# Autodesk Inventor assembly: ASSEMBLY_DUT_Ant_Rotator_REVB
(part 4 of 5)
- Mate:412: 3DP_PLA_B_Axis_Rotating_Stage_Fiberglass_pipes_mount_clamp:1 ↔ COTS_DREMEC_8G206M6X50_M6x50_Nylon_Screw:44
- Mate:413: 3DP_PLA_B_Axis_Rotating_Stage_Fiberglass_pipes_mount_clamp:1 ↔ COTS_DREMEC_8G206M6X50_M6x50_Nylon_Screw:43
- Mate:414: 3DP_PLA_B_Axis_Rotating_Stage_Fiberglass_pipes_mount_clamp:1 ↔ COTS_DREMEC_8G206M6X50_M6x50_Nylon_Screw:42
- Mate:415: 3DP_PLA_B_Axis_Rotating_Stage_Fiberglass_pipes_mount_clamp:1 ↔ COTS_DREMEC_8G206M6X50_M6x50_Nylon_Screw:45
- Mate:416: 3DP_PLA_B_Axis_Rotating_Stage_Fiberglass_pipes_mount_clamp:1 ↔ COTS_DREMEC_8G206M6X50_M6x50_Nylon_Screw:46
- Mate:417: 3DP_PLA_B_Axis_Rotating_Stage_Fiberglass_pipes_mount_clamp:1 ↔ COTS_DREMEC_8G206M6X50_M6x50_Nylon_Screw:47
- Mate:418: 3DP_PLA_B_Axis_Rotating_Stage_Fiberglass_pipes_mount_clamp:2 ↔ COTS_DREMEC_8G206M6X50_M6x50_Nylon_Screw:48
- Mate:419: 3DP_PLA_B_Axis_Rotating_Stage_Fiberglass_pipes_mount_clamp:2 ↔ COTS_DREMEC_8G206M6X50_M6x50_Nylon_Screw:49
- Mate:420: 3DP_PLA_B_Axis_Rotating_Stage_Fiberglass_pipes_mount_clamp:2 ↔ COTS_DREMEC_8G206M6X50_M6x50_Nylon_Screw:50
- Mate:421: 3DP_PLA_B_Axis_Rotating_Stage_Fiberglass_pipes_mount_clamp:2 ↔ COTS_DREMEC_8G206M6X50_M6x50_Nylon_Screw:51
- Mate:422: 3DP_PLA_B_Axis_Rotating_Stage_Fiberglass_pipes_mount_clamp:2 ↔ COTS_DREMEC_8G206M6X50_M6x50_Nylon_Screw:52
- Mate:423: 3DP_PLA_B_Axis_Rotating_Stage_Fiberglass_pipes_mount_clamp:2 ↔ COTS_DREMEC_8G206M6X50_M6x50_Nylon_Screw:53
- Mate:424: 3DP_PLA_B_Axis_Rotating_Stage_Fiberglass_pipes_mount_clamp:2 ↔ COTS_DREMEC_8G206M6X50_M6x50_Nylon_Screw:52
- Mate:425: 3DP_PLA_B_Axis_Rotating_Stage_Fiberglass_pipes_mount_clamp:2 ↔ COTS_DREMEC_8G206M6X50_M6x50_Nylon_Screw:50
- Mate:426: 3DP_PLA_B_Axis_Rotating_Stage_Fiberglass_pipes_mount_clamp:2 ↔ COTS_DREMEC_8G206M6X50_M6x50_Nylon_Screw:53
- Mate:427: 3DP_PLA_B_Axis_Rotating_Stage_Fiberglass_pipes_mount_clamp:2 ↔ COTS_DREMEC_8G206M6X50_M6x50_Nylon_Screw:49
- Mate:428: 3DP_PLA_B_Axis_Rotating_Stage_Fiberglass_pipes_mount_clamp:2 ↔ COTS_DREMEC_8G206M6X50_M6x50_Nylon_Screw:48
- Mate:429: 3DP_PLA_B_Axis_Rotating_Stage_Fiberglass_pipes_mount_clamp:2 ↔ COTS_DREMEC_8G206M6X50_M6x50_Nylon_Screw:51
- Mate:430: 3DP_PLA_B_Axis_Rotating_Stage_Fiberglass_pipes_mount_clamp:1 ↔ COTS_DREMEC_8G206M6X50_M6x50_Nylon_Screw:43
- Mate:431: 3DP_PLA_B_Axis_Rotating_Stage_Fiberglass_pipes_mount_clamp:1 ↔ COTS_DREMEC_8G206M6X50_M6x50_Nylon_Screw:42
- Mate:432: 3DP_PLA_B_Axis_Rotating_Stage_Fiberglass_pipes_mount_clamp:1 ↔ COTS_DREMEC_8G206M6X50_M6x50_Nylon_Screw:44
- Mate:433: 3DP_PLA_B_Axis_Rotating_Stage_Fiberglass_pipes_mount_clamp:1 ↔ COTS_DREMEC_8G206M6X50_M6x50_Nylon_Screw:46
- Mate:434: 3DP_PLA_B_Axis_Rotating_Stage_Fiberglass_pipes_mount_clamp:1 ↔ COTS_DREMEC_8G206M6X50_M6x50_Nylon_Screw:47
- Mate:435: 3DP_PLA_B_Axis_Rotating_Stage_Fiberglass_pipes_mount_clamp:1 ↔ COTS_DREMEC_8G206M6X50_M6x50_Nylon_Screw:45
- Mate:436: 3DP_PLA_B_Axis_Rotating_Stage:1 ↔ COTS_BOSSARD_1400444_M6_Nylon_Nut:44
- Mate:437: 3DP_PLA_B_Axis_Rotating_Stage:1 ↔ COTS_BOSSARD_1400444_M6_Nylon_Nut:47
- Mate:438: 3DP_PLA_B_Axis_Rotating_Stage:1 ↔ COTS_BOSSARD_1400444_M6_Nylon_Nut:50
- Mate:439: 3DP_PLA_B_Axis_Rotating_Stage:1 ↔ COTS_BOSSARD_1400444_M6_Nylon_Nut:53
- Mate:440: 3DP_PLA_B_Axis_Rotating_Stage:1 ↔ COTS_BOSSARD_1400444_M6_Nylon_Nut:52
- Mate:441: 3DP_PLA_B_Axis_Rotating_Stage:1 ↔ COTS_BOSSARD_1400444_M6_Nylon_Nut:49
- Mate:442: 3DP_PLA_B_Axis_Rotating_Stage:1 ↔ COTS_BOSSARD_1400444_M6_Nylon_Nut:46
- Mate:443: 3DP_PLA_B_Axis_Rotating_Stage:1 ↔ COTS_BOSSARD_1400444_M6_Nylon_Nut:43
- Mate:444: 3DP_PLA_B_Axis_Rotating_Stage:1 ↔ COTS_BOSSARD_1400444_M6_Nylon_Nut:42
- Mate:445: 3DP_PLA_B_Axis_Rotating_Stage:1 ↔ COTS_BOSSARD_1400444_M6_Nylon_Nut:51
- Mate:446: 3DP_PLA_B_Axis_Rotating_Stage:1 ↔ COTS_BOSSARD_1400444_M6_Nylon_Nut:45
- Mate:447: 3DP_PLA_B_Axis_Rotating_Stage:1 ↔ COTS_BOSSARD_1400444_M6_Nylon_Nut:48
- Mate:448: COTS_BOSSARD_1400444_M6_Nylon_Nut:48 ↔ COTS_DREMEC_8G206M6X50_M6x50_Nylon_Screw:43
- Mate:449: COTS_BOSSARD_1400444_M6_Nylon_Nut:45 ↔ COTS_DREMEC_8G206M6X50_M6x50_Nylon_Screw:47
- Mate:450: COTS_BOSSARD_1400444_M6_Nylon_Nut:51 ↔ COTS_DREMEC_8G206M6X50_M6x50_Nylon_Screw:44
- Mate:451: COTS_BOSSARD_1400444_M6_Nylon_Nut:46 ↔ COTS_DREMEC_8G206M6X50_M6x50_Nylon_Screw:46
- Mate:452: COTS_BOSSARD_1400444_M6_Nylon_Nut:43 ↔ COTS_DREMEC_8G206M6X50_M6x50_Nylon_Screw:45
- Mate:453: COTS_BOSSARD_1400444_M6_Nylon_Nut:42 ↔ COTS_DREMEC_8G206M6X50_M6x50_Nylon_Screw:42
- Mate:454: COTS_BOSSARD_1400444_M6_Nylon_Nut:50 ↔ COTS_DREMEC_8G206M6X50_M6x50_Nylon_Screw:52
- Mate:455: COTS_BOSSARD_1400444_M6_Nylon_Nut:49 ↔ COTS_DREMEC_8G206M6X50_M6x50_Nylon_Screw:50
- Mate:456: COTS_BOSSARD_1400444_M6_Nylon_Nut:47 ↔ COTS_DREMEC_8G206M6X50_M6x50_Nylon_Screw:53
- Mate:457: COTS_BOSSARD_1400444_M6_Nylon_Nut:52 ↔ COTS_DREMEC_8G206M6X50_M6x50_Nylon_Screw:49
- Mate:458: COTS_BOSSARD_1400444_M6_Nylon_Nut:44 ↔ COTS_DREMEC_8G206M6X50_M6x50_Nylon_Screw:48
- Mate:459: COTS_BOSSARD_1400444_M6_Nylon_Nut:53 ↔ COTS_DREMEC_8G206M6X50_M6x50_Nylon_Screw:51
- Angle:44 (0 deg): 3DP_PLA_B_Axis_Rotating_Stage:1 ↔ COTS_BOSSARD_1400444_M6_Nylon_Nut:44
- Angle:45 (0 deg): 3DP_PLA_B_Axis_Rotating_Stage:1 ↔ COTS_BOSSARD_1400444_M6_Nylon_Nut:53
- Angle:46 (0 deg): 3DP_PLA_B_Axis_Rotating_Stage:1 ↔ COTS_BOSSARD_1400444_M6_Nylon_Nut:52
- Angle:47 (0 deg): 3DP_PLA_B_Axis_Rotating_Stage:1 ↔ COTS_BOSSARD_1400444_M6_Nylon_Nut:47
- Angle:48 (0 deg): 3DP_PLA_B_Axis_Rotating_Stage:1 ↔ COTS_BOSSARD_1400444_M6_Nylon_Nut:50
- Angle:49 (0 deg): 3DP_PLA_B_Axis_Rotating_Stage:1 ↔ COTS_BOSSARD_1400444_M6_Nylon_Nut:49
- Angle:50 (0 deg): 3DP_PLA_B_Axis_Rotating_Stage:1 ↔ COTS_BOSSARD_1400444_M6_Nylon_Nut:42
- Angle:51 (0 deg): 3DP_PLA_B_Axis_Rotating_Stage:1 ↔ COTS_BOSSARD_1400444_M6_Nylon_Nut:48
- Angle:52 (0 deg): 3DP_PLA_B_Axis_Rotating_Stage:1 ↔ COTS_BOSSARD_1400444_M6_Nylon_Nut:43
- Angle:53 (0 deg): 3DP_PLA_B_Axis_Rotating_Stage:1 ↔ COTS_BOSSARD_1400444_M6_Nylon_Nut:45
- Angle:54 (-90 deg): 3DP_PLA_Fiberglass_Pipe_Corner_Bracket:2 ↔ 3DP_PLA_B_Axis_Bearing_Mounting_Plate:1
- Mate:460: 3DP_PLA_B_Axis_Main_Pulley:1 ↔ 3DP_PLA_B_Axis_Rotating_Stage:1
- Mate:461: 3DP_PLA_B_Axis_Main_Pulley:1 ↔ COTS_DREMEC_8G206M6X50_M6x50_Nylon_Screw:55
- Mate:462: 3DP_PLA_B_Axis_Main_Pulley:1 ↔ COTS_DREMEC_8G206M6X50_M6x50_Nylon_Screw:54
- Mate:463: 3DP_PLA_B_Axis_Main_Pulley:1 ↔ COTS_DREMEC_8G206M6X50_M6x50_Nylon_Screw:56
- Mate:464: 3DP_PLA_B_Axis_Main_Pulley:1 ↔ COTS_DREMEC_8G206M6X50_M6x50_Nylon_Screw:57
- Mate:465: 3DP_PLA_B_Axis_Main_Pulley:1 ↔ COTS_DREMEC_8G206M6X50_M6x50_Nylon_Screw:59
- Mate:466: 3DP_PLA_B_Axis_Main_Pulley:1 ↔ COTS_DREMEC_8G206M6X50_M6x50_Nylon_Screw:58
- Mate:467: 3DP_PLA_B_Axis_Main_Pulley:1 ↔ COTS_DREMEC_8G206M6X50_M6x50_Nylon_Screw:54
- Mate:468: 3DP_PLA_B_Axis_Main_Pulley:1 ↔ COTS_DREMEC_8G206M6X50_M6x50_Nylon_Screw:56
- Mate:469: 3DP_PLA_B_Axis_Main_Pulley:1 ↔ COTS_DREMEC_8G206M6X50_M6x50_Nylon_Screw:58
- Mate:470: 3DP_PLA_B_Axis_Main_Pulley:1 ↔ COTS_DREMEC_8G206M6X50_M6x50_Nylon_Screw:59
- Mate:471: 3DP_PLA_B_Axis_Main_Pulley:1 ↔ COTS_DREMEC_8G206M6X50_M6x50_Nylon_Screw:57
- Mate:472: 3DP_PLA_B_Axis_Main_Pulley:1 ↔ COTS_DREMEC_8G206M6X50_M6x50_Nylon_Screw:55
- Mate:473: 3DP_PLA_B_Axis_Rotating_Stage:1 ↔ COTS_BOSSARD_1400444_M6_Nylon_Nut:55
- Mate:474: 3DP_PLA_B_Axis_Rotating_Stage:1 ↔ COTS_BOSSARD_1400444_M6_Nylon_Nut:54
- Mate:475: 3DP_PLA_B_Axis_Rotating_Stage:1 ↔ COTS_BOSSARD_1400444_M6_Nylon_Nut:56
- Mate:476: 3DP_PLA_B_Axis_Rotating_Stage:1 ↔ COTS_BOSSARD_1400444_M6_Nylon_Nut:57
- Mate:477: 3DP_PLA_B_Axis_Rotating_Stage:1 ↔ COTS_BOSSARD_1400444_M6_Nylon_Nut:59
- Mate:478: 3DP_PLA_B_Axis_Rotating_Stage:1 ↔ COTS_BOSSARD_1400444_M6_Nylon_Nut:58
- Mate:479: COTS_BOSSARD_1400444_M6_Nylon_Nut:59 ↔ COTS_DREMEC_8G206M6X50_M6x50_Nylon_Screw:55
- Mate:480: COTS_BOSSARD_1400444_M6_Nylon_Nut:58 ↔ COTS_DREMEC_8G206M6X50_M6x50_Nylon_Screw:57
- Mate:481: COTS_BOSSARD_1400444_M6_Nylon_Nut:55 ↔ COTS_DREMEC_8G206M6X50_M6x50_Nylon_Screw:54
- Mate:482: COTS_BOSSARD_1400444_M6_Nylon_Nut:54 ↔ COTS_DREMEC_8G206M6X50_M6x50_Nylon_Screw:56
- Mate:483: COTS_BOSSARD_1400444_M6_Nylon_Nut:56 ↔ COTS_DREMEC_8G206M6X50_M6x50_Nylon_Screw:58
- Mate:484: COTS_BOSSARD_1400444_M6_Nylon_Nut:57 ↔ COTS_DREMEC_8G206M6X50_M6x50_Nylon_Screw:59
- Angle:55 (0 deg): 3DP_PLA_B_Axis_Rotating_Stage:1 ↔ COTS_BOSSARD_1400444_M6_Nylon_Nut:55
- Angle:56 (0 deg): 3DP_PLA_B_Axis_Rotating_Stage:1 ↔ COTS_BOSSARD_1400444_M6_Nylon_Nut:54
- Angle:57 (0 deg): 3DP_PLA_B_Axis_Rotating_Stage:1 ↔ COTS_BOSSARD_1400444_M6_Nylon_Nut:56
- Angle:58 (0 deg): 3DP_PLA_B_Axis_Rotating_Stage:1 ↔ COTS_BOSSARD_1400444_M6_Nylon_Nut:57
- Angle:59 (0 deg): 3DP_PLA_B_Axis_Rotating_Stage:1 ↔ COTS_BOSSARD_1400444_M6_Nylon_Nut:58
- Angle:60 (0 deg): 3DP_PLA_B_Axis_Rotating_Stage:1 ↔ COTS_BOSSARD_1400444_M6_Nylon_Nut:59
- Mate:485: COTS_GENERIC_6016_80x125x22mm_POM_Ball_Bearing:1 ↔ 3DP_PLA_B_Axis_End_Cap:1
- Mate:486: 3DP_PLA_B_Axis_Main_Pulley:1 ↔ 3DP_PLA_B_Axis_End_Cap:1
- Mate:487: 3DP_PLA_B_Axis_Main_Pulley:1 ↔ 3DP_PLA_B_Axis_End_Cap:1
- Mate:488: 3DP_PLA_B_Axis_Main_Pulley:1 ↔ COTS_DREMEC_8G206M6X50_M6x50_Nylon_Screw:62
- Mate:489: 3DP_PLA_B_Axis_Main_Pulley:1 ↔ COTS_DREMEC_8G206M6X50_M6x50_Nylon_Screw:61
- Mate:490: 3DP_PLA_B_Axis_Main_Pulley:1 ↔ COTS_DREMEC_8G206M6X50_M6x50_Nylon_Screw:60
- Mate:491: 3DP_PLA_B_Axis_Main_Pulley:1 ↔ COTS_DREMEC_8G206M6X50_M6x50_Nylon_Screw:61
- Mate:492: 3DP_PLA_B_Axis_Main_Pulley:1 ↔ COTS_DREMEC_8G206M6X50_M6x50_Nylon_Screw:60
- Mate:493: 3DP_PLA_B_Axis_Main_Pulley:1 ↔ COTS_DREMEC_8G206M6X50_M6x50_Nylon_Screw:62
- Mate:494: 3DP_PLA_B_Axis_End_Cap:1 ↔ COTS_BOSSARD_1400444_M6_Nylon_Nut:61
- Mate:495: 3DP_PLA_B_Axis_End_Cap:1 ↔ COTS_BOSSARD_1400444_M6_Nylon_Nut:62
- Mate:496: 3DP_PLA_B_Axis_End_Cap:1 ↔ COTS_BOSSARD_1400444_M6_Nylon_Nut:60
- Mate:497: COTS_BOSSARD_1400444_M6_Nylon_Nut:60 ↔ COTS_DREMEC_8G206M6X50_M6x50_Nylon_Screw:62
- Mate:498: COTS_BOSSARD_1400444_M6_Nylon_Nut:62 ↔ COTS_DREMEC_8G206M6X50_M6x50_Nylon_Screw:60
- Mate:499: COTS_BOSSARD_1400444_M6_Nylon_Nut:61 ↔ COTS_DREMEC_8G206M6X50_M6x50_Nylon_Screw:61
- Angle:61 (0 deg): 3DP_PLA_B_Axis_End_Cap:1 ↔ COTS_BOSSARD_1400444_M6_Nylon_Nut:61
- Angle:62 (0 deg): 3DP_PLA_B_Axis_End_Cap:1 ↔ COTS_BOSSARD_1400444_M6_Nylon_Nut:62
- Angle:63 (0 deg): 3DP_PLA_B_Axis_End_Cap:1 ↔ COTS_BOSSARD_1400444_M6_Nylon_Nut:60
- Mate:500: COTS_CARBONCENTER_Fiberglass_Tube_27x24x383mm:8 ↔ 3DP_PLA_Antenna_Boom_Coax_Feed_Horn_REVB:1
- Mate:501: COTS_CARBONCENTER_Fiberglass_Tube_27x24x383mm:7 ↔ 3DP_PLA_Antenna_Boom_Coax_Feed_Horn_REVB:1
- Flush:22 (102.5 mm): COTS_CARBONCENTER_Fiberglass_Tube_27x24x383mm:8 ↔ 3DP_PLA_Antenna_Boom_Coax_Feed_Horn_REVB:1
- Mate:502: COTS_CARBONCENTER_Fiberglass_Tube_27x24x383mm:8 ↔ 3DP_PLA_Antenna_Boom_Fiberglass_Pipe_Clamp:1
- Mate:503: COTS_CARBONCENTER_Fiberglass_Tube_27x24x383mm:7 ↔ 3DP_PLA_Antenna_Boom_Fiberglass_Pipe_Clamp:1
- Flush:23: 3DP_PLA_Antenna_Boom_Fiberglass_Pipe_Clamp:1 ↔ 3DP_PLA_Antenna_Boom_Coax_Feed_Horn_REVB:1
- Mate:504: 3DP_PLA_Antenna_Boom_Coax_Feed_Horn_REVB:1 ↔ COTS_DREMEC_8G206M6X50_M6x50_Nylon_Screw:63
- Mate:505: 3DP_PLA_Antenna_Boom_Coax_Feed_Horn_REVB:1 ↔ COTS_DREMEC_8G206M6X50_M6x50_Nylon_Screw:64
- Mate:506: 3DP_PLA_Antenna_Boom_Coax_Feed_Horn_REVB:1 ↔ COTS_DREMEC_8G206M6X50_M6x50_Nylon_Screw:65
- Mate:507: 3DP_PLA_Antenna_Boom_Coax_Feed_Horn_REVB:1 ↔ COTS_DREMEC_8G206M6X50_M6x50_Nylon_Screw:66
- Mate:508: 3DP_PLA_Antenna_Boom_Coax_Feed_Horn_REVB:1 ↔ COTS_DREMEC_8G206M6X50_M6x50_Nylon_Screw:66
- Mate:509: 3DP_PLA_Antenna_Boom_Coax_Feed_Horn_REVB:1 ↔ COTS_DREMEC_8G206M6X50_M6x50_Nylon_Screw:64
- Mate:510: 3DP_PLA_Antenna_Boom_Coax_Feed_Horn_REVB:1 ↔ COTS_DREMEC_8G206M6X50_M6x50_Nylon_Screw:63
- Mate:511: 3DP_PLA_Antenna_Boom_Coax_Feed_Horn_REVB:1 ↔ COTS_DREMEC_8G206M6X50_M6x50_Nylon_Screw:65
- Mate:512: 3DP_PLA_Antenna_Boom_Fiberglass_Pipe_Clamp:1 ↔ COTS_BOSSARD_1400444_M6_Nylon_Nut:63
- Mate:513: 3DP_PLA_Antenna_Boom_Fiberglass_Pipe_Clamp:1 ↔ COTS_BOSSARD_1400444_M6_Nylon_Nut:66
- Mate:514: 3DP_PLA_Antenna_Boom_Fiberglass_Pipe_Clamp:1 ↔ COTS_BOSSARD_1400444_M6_Nylon_Nut:65
- Mate:515: 3DP_PLA_Antenna_Boom_Fiberglass_Pipe_Clamp:1 ↔ COTS_BOSSARD_1400444_M6_Nylon_Nut:64
- Mate:516: COTS_BOSSARD_1400444_M6_Nylon_Nut:64 ↔ COTS_DREMEC_8G206M6X50_M6x50_Nylon_Screw:66
- Mate:517: COTS_BOSSARD_1400444_M6_Nylon_Nut:66 ↔ COTS_DREMEC_8G206M6X50_M6x50_Nylon_Screw:64
- Mate:518: COTS_BOSSARD_1400444_M6_Nylon_Nut:63 ↔ COTS_DREMEC_8G206M6X50_M6x50_Nylon_Screw:63
- Mate:519: COTS_BOSSARD_1400444_M6_Nylon_Nut:65 ↔ COTS_DREMEC_8G206M6X50_M6x50_Nylon_Screw:65
- Mate:520: COTS_BYTECHLAB_Coaxial_Feed_Horn:1 ↔ 3DP_PLA_Antenna_Boom_Coax_Feed_Horn_REVB:1
- Mate:521: COTS_BYTECHLAB_Coaxial_Feed_Horn:1 ↔ 3DP_PLA_Antenna_Boom_Coax_Feed_Horn_REVB:1
- Mate:522: COTS_BYTECHLAB_Coaxial_Feed_Horn:1 ↔ 3DP_PLA_Antenna_Boom_Coax_Feed_Horn_REVB:1
- Mate:576: 3DP_PLA_A_Axis_Bearing_Base:1 ↔ COTS_Profihot_HC-2-22x16_Zip_Tie_Anchor:1
- Angle:64 (0 deg): 3DP_PLA_A_Axis_Bearing_Base:1 ↔ COTS_Profihot_HC-2-22x16_Zip_Tie_Anchor:1
- Mate:577: 3DP_PLA_A_Axis_Bearing_Base:1 ↔ COTS_BOSSARD_1386883_M4_Threaded_Insert:1
- Flush:24: 3DP_PLA_A_Axis_Bearing_Base:1 ↔ COTS_BOSSARD_1386883_M4_Threaded_Insert:1
- Mate:578: COTS_Profihot_HC-2-22x16_Zip_Tie_Anchor:1 ↔ COTS_BOSSARD_1386883_M4_Threaded_Insert:1
- Mate:579: COTS_Profihot_HC-2-22x16_Zip_Tie_Anchor:1 ↔ DIN 125-1 A A 4,3:1
- Mate:580: COTS_Profihot_HC-2-22x16_Zip_Tie_Anchor:1 ↔ DIN 125-1 A A 4,3:1
- Insert:9: DIN 125-1 A A 4,3:1 ↔ ISO 7380-1 M4 x 8:1
- Mate:581: 3DP_PLA_Fiberglass_Pipe_Corner_Bracket_Clamp_and_B_axis_Stepper_Mount_REVB:1 ↔ COTS_Profihot_HC-2-22x16_Zip_Tie_Anchor:2
- Angle:65 (0 deg): COTS_MKS_SERVO42D_40mm:2 ↔ COTS_Profihot_HC-2-22x16_Zip_Tie_Anchor:2
- Mate:582: 3DP_PLA_Fiberglass_Pipe_Corner_Bracket_Clamp_and_B_axis_Stepper_Mount_REVB:1 ↔ DIN 125-1 A A 4,3:2
- Mate:583: COTS_Profihot_HC-2-22x16_Zip_Tie_Anchor:2 ↔ DIN 125-1 A A 4,3:2
- Insert:10: DIN 125-1 A A 4,3:2 ↔ ISO 7380-1 M4 x 16:1
- Mate:584: 3DP_PLA_Fiberglass_Pipe_Corner_Bracket_Clamp_and_B_axis_Stepper_Mount_REVB:1 ↔ DIN 125-1 A A 4,3:3
- Mate:585: 3DP_PLA_Fiberglass_Pipe_Corner_Bracket_Clamp_and_B_axis_Stepper_Mount_REVB:1 ↔ DIN 125-1 A A 4,3:3
- Insert:11: DIN 125-1 A A 4,3:3 ↔ DIN 934 - replaced by DIN EN 24032/28673/28674 M4:24
- Mate:586: 3DP_PLA_B_Axis_Bearing_Mounting_Plate:2 ↔ COTS_Profihot_HC-2-22x16_Zip_Tie_Anchor:3
- Angle:66 (0 deg): 3DP_PLA_B_Axis_Bearing_Mounting_Plate:2 ↔ COTS_Profihot_HC-2-22x16_Zip_Tie_Anchor:3
- Mate:587: 3DP_PLA_B_Axis_Bearing_Mounting_Plate:2 ↔ COTS_Profihot_HC-2-22x16_Zip_Tie_Anchor:3
- Mate:588: 3DP_PLA_B_Axis_Bearing_Mounting_Plate:2 ↔ COTS_DREMEC_8G206M5X08_M5x8_Nylon_Screw:1
- Mate:589: COTS_Profihot_HC-2-22x16_Zip_Tie_Anchor:3 ↔ COTS_DREMEC_8G206M5X08_M5x8_Nylon_Screw:1
- Mate:590: COTS_CARBONCENTER_Fiberglass_Tube_27x24x383mm:5 ↔ 3DP_PLA_B_Axis_Cable_Galnd:1
- Mate:591: COTS_CARBONCENTER_Fiberglass_Tube_27x24x383mm:5 ↔ 3DP_PLA_B_Axis_Cable_Galnd:1
- Mate:592: ASSEMBLY_HTD3M_Idler_A_Axis:2 ↔ 3DP_PLA_A_Axis_Idler_Stiffening_Bracket:1
- Mate:593: ASSEMBLY_HTD3M_Idler_A_Axis:2 ↔ 3DP_PLA_A_Axis_Idler_Stiffening_Bracket:1
- Mate:594: ASSEMBLY_HTD3M_Idler_A_Axis:1 ↔ 3DP_PLA_A_Axis_Idler_Stiffening_Bracket:1
- Mate:595: 3DP_PLA_A_Axis_Idler_Stiffening_Bracket:1 ↔ DIN 912 - replaced by DIN EN ISO 4762 M4 x 35:3
- Mate:596: 3DP_PLA_A_Axis_Idler_Stiffening_Bracket:1 ↔ DIN 912 - replaced by DIN EN ISO 4762 M4 x 35:3
- Mate:597: 3DP_PLA_A_Axis_Idler_Stiffening_Bracket:1 ↔ DIN 912 - replaced by DIN EN ISO 4762 M4 x 35:4
- Mate:598: 3DP_PLA_A_Axis_Idler_Stiffening_Bracket:1 ↔ DIN 912 - replaced by DIN EN ISO 4762 M4 x 35:4
- Mate:599: 3DP_PLA_A_Axis_Idler_Stiffening_Bracket:1 ↔ DIN 934 - replaced by DIN EN 24032/28673/28674 M4:25
- Mate:600: 3DP_PLA_A_Axis_Stepper_Mount_REVB:1 ↔ DIN 934 - replaced by DIN EN 24032/28673/28674 M4:25
- Mate:601: 3DP_PLA_A_Axis_Idler_Stiffening_Bracket:1 ↔ DIN 934 - replaced by DIN EN 24032/28673/28674 M4:26
- Mate:602: 3DP_PLA_A_Axis_Stepper_Mount_REVB:1 ↔ DIN 934 - replaced by DIN EN 24032/28673/28674 M4:26
- Mate:603: ASSEMBLY_HTD3M_Idler_B_Axis:2 ↔ 3DP_PLA_B_Axis_Idler_Stiffening_Bracket:1
- Mate:604: ASSEMBLY_HTD3M_Idler_B_Axis:2 ↔ 3DP_PLA_B_Axis_Idler_Stiffening_Bracket:1
- Mate:605: ASSEMBLY_HTD3M_Idler_B_Axis:1 ↔ 3DP_PLA_B_Axis_Idler_Stiffening_Bracket:1
- Mate:606: 3DP_PLA_B_Axis_Idler_Stiffening_Bracket:1 ↔ ISO 7380-1 M4 x 40:12
- Mate:607: 3DP_PLA_B_Axis_Idler_Stiffening_Bracket:1 ↔ ISO 7380-1 M4 x 40:12
- Mate:608: 3DP_PLA_B_Axis_Idler_Stiffening_Bracket:1 ↔ ISO 7380-1 M4 x 40:13
- Mate:609: 3DP_PLA_B_Axis_Idler_Stiffening_Bracket:1 ↔ ISO 7380-1 M4 x 40:13
- Mate:610: 3DP_PLA_B_Axis_Idler_Stiffening_Bracket:1 ↔ DIN 934 - replaced by DIN EN 24032/28673/28674 M4:27
- Mate:611: 3DP_PLA_Fiberglass_Pipe_Corner_Bracket_Clamp_and_B_axis_Stepper_Mount_REVB:1 ↔ DIN 934 - replaced by DIN EN 24032/28673/28674 M4:27
- Mate:612: 3DP_PLA_B_Axis_Idler_Stiffening_Bracket:1 ↔ DIN 934 - replaced by DIN EN 24032/28673/28674 M4:28
- Mate:613: 3DP_PLA_Fiberglass_Pipe_Corner_Bracket_Clamp_and_B_axis_Stepper_Mount_REVB:1 ↔ DIN 934 - replaced by DIN EN 24032/28673/28674 M4:28
- Mate:625: 3DP_PLA_A_Axis_Bearing_Base:1 ↔ 3DP_PLA_A_Axis_Bearing_Base_Stand_Mount_REVB:1
- Mate:627: 3DP_PLA_A_Axis_Bearing_Base:1 ↔ 3DP_PLA_A_Axis_Bearing_Base_Stand_Mount_REVB:1
- Mate:629: 3DP_PLA_A_Axis_Bearing_Base_Stand_Mount_REVB:1 ↔ COTS_Fleximo_FB12020_20x20_Alu_Profile_150mm:1
- Mate:630 (0.1 mm): 3DP_PLA_A_Axis_Bearing_Base_Stand_Mount_REVB:1 ↔ COTS_Fleximo_FB12020_20x20_Alu_Profile_150mm:1
- Mate:632: COTS_Fleximo_FB12020_20x20_Alu_Profile_600mm:1 ↔ COTS_Fleximo_FB12020_20x20_Alu_Profile_150mm:1
- Flush:25: COTS_Fleximo_FB12020_20x20_Alu_Profile_600mm:1 ↔ COTS_Fleximo_FB12020_20x20_Alu_Profile_150mm:1
- Flush:26: COTS_Fleximo_FB12020_20x20_Alu_Profile_600mm:1 ↔ COTS_Fleximo_FB12020_20x20_Alu_Profile_150mm:1
- Mate:633: COTS_Fleximo_FB12020_20x20_Alu_Profile_600mm:1 ↔ COTS_Fleximo_FB12020_20x20_Alu_Profile_150mm:2
- Flush:27: COTS_Fleximo_FB12020_20x20_Alu_Profile_600mm:1 ↔ COTS_Fleximo_FB12020_20x20_Alu_Profile_150mm:2
- Flush:28: COTS_Fleximo_FB12020_20x20_Alu_Profile_600mm:1 ↔ COTS_Fleximo_FB12020_20x20_Alu_Profile_150mm:2
- Mate:634: COTS_Fleximo_FB12020_20x20_Alu_Profile_600mm:1 ↔ COTS_Fleximo_FB1K2020_Angle:1
- Mate:635: COTS_Fleximo_FB1K2020_Angle:1 ↔ COTS_Fleximo_FB12020_20x20_Alu_Profile_150mm:2
- Flush:29 (-1 mm): COTS_Fleximo_FB12020_20x20_Alu_Profile_600mm:1 ↔ COTS_Fleximo_FB1K2020_Angle:1
- Mate:636: COTS_Fleximo_FB1K2020_Angle:2 ↔ COTS_Fleximo_FB12020_20x20_Alu_Profile_150mm:1
- Mate:637: COTS_Fleximo_FB12020_20x20_Alu_Profile_600mm:1 ↔ COTS_Fleximo_FB1K2020_Angle:2
- Flush:30 (1 mm): COTS_Fleximo_FB12020_20x20_Alu_Profile_600mm:1 ↔ COTS_Fleximo_FB1K2020_Angle:2
- Mate:639: COTS_Fleximo_FB12020_20x20_Alu_Profile_600mm:1 ↔ COTS_Fleximo_FBP2020_20x20_Hinge:1
- Flush:33: COTS_Fleximo_FB12020_20x20_Alu_Profile_600mm:1 ↔ COTS_Fleximo_FBP2020_20x20_Hinge:1
- Flush:34 (-25 mm): COTS_Fleximo_FB12020_20x20_Alu_Profile_600mm:1 ↔ COTS_Fleximo_FBP2020_20x20_Hinge:1
- Mate:640: COTS_Fleximo_FB12020_20x20_Alu_Profile_575mm:1 ↔ COTS_Fleximo_FBP2020_20x20_Hinge:1
- Flush:35: COTS_Fleximo_FB12020_20x20_Alu_Profile_575mm:1 ↔ COTS_Fleximo_FBP2020_20x20_Hinge:1
- Flush:36: COTS_Fleximo_FB12020_20x20_Alu_Profile_575mm:1 ↔ COTS_Fleximo_FBP2020_20x20_Hinge:1
- Mate:641: COTS_Fleximo_FB12020_20x20_Alu_Profile_575mm:1 ↔ COTS_Fleximo_FB1ZP20C_20x20_End_Cap:2
- Flush:37: COTS_Fleximo_FB12020_20x20_Alu_Profile_575mm:1 ↔ COTS_Fleximo_FB1ZP20C_20x20_End_Cap:2
- Flush:38: COTS_Fleximo_FB12020_20x20_Alu_Profile_575mm:1 ↔ COTS_Fleximo_FB1ZP20C_20x20_End_Cap:2
- Mate:642: COTS_Fleximo_FB12020_20x20_Alu_Profile_575mm:1 ↔ COTS_Fleximo_FB1ZP20C_20x20_End_Cap:3
- Flush:39: COTS_Fleximo_FB12020_20x20_Alu_Profile_575mm:1 ↔ COTS_Fleximo_FB1ZP20C_20x20_End_Cap:3
- Flush:40: COTS_Fleximo_FB12020_20x20_Alu_Profile_575mm:1 ↔ COTS_Fleximo_FB1ZP20C_20x20_End_Cap:3
- Mate:643: COTS_Fleximo_FB12020_20x20_Alu_Profile_575mm:1 ↔ 3DP_PLA_Foldable_Leg_Brace_Mount_REVB:1
- Flush:41: COTS_Fleximo_FB12020_20x20_Alu_Profile_575mm:1 ↔ 3DP_PLA_Foldable_Leg_Brace_Mount_REVB:1
- Mate:644: 3DP_PLA_Foldable_Leg_Brace_Mount_REVB:1 ↔ COTS_Fleximo_FB1ZP20C_20x20_End_Cap:3
- Mate:645: COTS_Fleximo_FB12020_20x20_Alu_Profile_600mm:1 ↔ 3DP_PLA_Foldable_Leg_Brace_Mount_REVB:2
- Flush:42: COTS_Fleximo_FB12020_20x20_Alu_Profile_600mm:1 ↔ 3DP_PLA_Foldable_Leg_Brace_Mount_REVB:2
- Mate:647: 3DP_PLA_Foldable_Leg_Brace_Mount_REVB:1 ↔ COTS_GENERIC_5mm_Carbon_Rod:1
- Mate:648: 3DP_PLA_Foldable_Leg_Brace_Mount_REVB:1 ↔ COTS_GENERIC_5mm_Carbon_Rod:1
- Mate:649: COTS_Fleximo_FB12020_20x20_Alu_Profile_575mm:1 ↔ COTS_Fleximo_FB1NM3_M3_Nut_20x20:1
- Mate:650: COTS_Fleximo_FB12020_20x20_Alu_Profile_575mm:1 ↔ COTS_Fleximo_FB1NM3_M3_Nut_20x20:4
- Angle:67 (0 deg): COTS_Fleximo_FB12020_20x20_Alu_Profile_575mm:1 ↔ COTS_Fleximo_FB1NM3_M3_Nut_20x20:4
- Angle:68 (0 deg): COTS_Fleximo_FB12020_20x20_Alu_Profile_575mm:1 ↔ COTS_Fleximo_FB1NM3_M3_Nut_20x20:1
- Mate:651: 3DP_PLA_Foldable_Leg_Brace_Mount_REVB:1 ↔ COTS_Fleximo_FB1NM3_M3_Nut_20x20:4
- Mate:652: 3DP_PLA_Foldable_Leg_Brace_Mount_REVB:1 ↔ COTS_Fleximo_FB1NM3_M3_Nut_20x20:1
- Mate:653: COTS_Fleximo_FB12020_20x20_Alu_Profile_600mm:1 ↔ COTS_Fleximo_FB1NM3_M3_Nut_20x20:3
- Mate:654: COTS_Fleximo_FB12020_20x20_Alu_Profile_600mm:1 ↔ COTS_Fleximo_FB1NM3_M3_Nut_20x20:2
- Angle:69 (0 deg): COTS_Fleximo_FB12020_20x20_Alu_Profile_600mm:1 ↔ COTS_Fleximo_FB1NM3_M3_Nut_20x20:2
- Angle:70 (0 deg): COTS_Fleximo_FB12020_20x20_Alu_Profile_600mm:1 ↔ COTS_Fleximo_FB1NM3_M3_Nut_20x20:3
- Mate:655: 3DP_PLA_Foldable_Leg_Brace_Mount_REVB:2 ↔ COTS_Fleximo_FB1NM3_M3_Nut_20x20:2
- Mate:656: 3DP_PLA_Foldable_Leg_Brace_Mount_REVB:2 ↔ COTS_Fleximo_FB1NM3_M3_Nut_20x20:3
- Mate:657: 3DP_PLA_Foldable_Leg_Brace_Mount_REVB:1 ↔ ISO 7380-1 M3 x 12:1
- Mate:658: 3DP_PLA_Foldable_Leg_Brace_Mount_REVB:1 ↔ ISO 7380-1 M3 x 12:1
- Mate:659: 3DP_PLA_Foldable_Leg_Brace_Mount_REVB:1 ↔ ISO 7380-1 M3 x 12:2
- Mate:660: 3DP_PLA_Foldable_Leg_Brace_Mount_REVB:1 ↔ ISO 7380-1 M3 x 12:2
- Mate:661: 3DP_PLA_Foldable_Leg_Brace_Mount_REVB:2 ↔ ISO 7380-1 M3 x 12:3
- Mate:662: 3DP_PLA_Foldable_Leg_Brace_Mount_REVB:2 ↔ ISO 7380-1 M3 x 12:3
- Mate:663: 3DP_PLA_Foldable_Leg_Brace_Mount_REVB:2 ↔ ISO 7380-1 M3 x 12:4
- Mate:664: 3DP_PLA_Foldable_Leg_Brace_Mount_REVB:2 ↔ ISO 7380-1 M3 x 12:4
- Mate:690: 3DP_PLA_A_Axis_Bearing_Base_Stand_Mount_REVB:1 ↔ COTS_Fleximo_FB12020_20x20_Alu_Profile_150mm:1
- Mate:691: 3DP_PLA_A_Axis_Bearing_Base_Stand_Mount_Bottom_REVB:1 ↔ COTS_Fleximo_FB12020_20x20_Alu_Profile_150mm:1
- Mate:729: COTS_Fleximo_FB12020_20x20_Alu_Profile_150mm:1 ↔ COTS_Fleximo_FB1NM4_M4_Nut_20x20:1
- Angle:71 (0 deg): COTS_Fleximo_FB12020_20x20_Alu_Profile_150mm:1 ↔ COTS_Fleximo_FB1NM4_M4_Nut_20x20:1
- Mate:730: 3DP_PLA_A_Axis_Bearing_Base_Stand_Mount_Bottom_REVB:1 ↔ COTS_Fleximo_FB1NM4_M4_Nut_20x20:1
- Mate:731 (0.1 mm): 3DP_PLA_A_Axis_Bearing_Base_Stand_Mount_Bottom_REVB:1 ↔ COTS_Fleximo_FB12020_20x20_Alu_Profile_150mm:1
- Mate:732: 3DP_PLA_A_Axis_Bearing_Base_Stand_Mount_Bottom_REVB:1 ↔ DIN 125-1 A A 5,3:7
- Mate:733: 3DP_PLA_A_Axis_Bearing_Base_Stand_Mount_Bottom_REVB:1 ↔ DIN 125-1 A A 5,3:7
- Mate:734: 3DP_PLA_A_Axis_Bearing_Base_Stand_Mount_Bottom_REVB:1 ↔ DIN 125-1 A A 5,3:8
- Mate:735: 3DP_PLA_A_Axis_Bearing_Base_Stand_Mount_Bottom_REVB:1 ↔ DIN 125-1 A A 5,3:8
- Mate:736: 3DP_PLA_A_Axis_Bearing_Base_Stand_Mount_Bottom_REVB:1 ↔ DIN 125-1 A A 5,3:9
- Mate:737: 3DP_PLA_A_Axis_Bearing_Base_Stand_Mount_Bottom_REVB:1 ↔ DIN 125-1 A A 5,3:9
- Mate:738: 3DP_PLA_A_Axis_Bearing_Base_Stand_Mount_Bottom_REVB:1 ↔ DIN 125-1 A A 5,3:10
- Mate:739: 3DP_PLA_A_Axis_Bearing_Base_Stand_Mount_Bottom_REVB:1 ↔ DIN 125-1 A A 5,3:10
- Mate:740: 3DP_PLA_A_Axis_Bearing_Base_Stand_Mount_Bottom_REVB:1 ↔ DIN 125-1 A A 5,3:11
- Mate:741: 3DP_PLA_A_Axis_Bearing_Base_Stand_Mount_Bottom_REVB:1 ↔ DIN 125-1 A A 5,3:11
- Mate:742: 3DP_PLA_A_Axis_Bearing_Base_Stand_Mount_Bottom_REVB:1 ↔ DIN 125-1 A A 5,3:12
- Mate:743: 3DP_PLA_A_Axis_Bearing_Base_Stand_Mount_Bottom_REVB:1 ↔ DIN 125-1 A A 5,3:12
- Mate:744: 3DP_PLA_A_Axis_Bearing_Base_Stand_Mount_Bottom_REVB:1 ↔ DIN 125-1 A A 5,3:13
- Mate:745: 3DP_PLA_A_Axis_Bearing_Base_Stand_Mount_Bottom_REVB:1 ↔ DIN 125-1 A A 5,3:13
- Mate:746: 3DP_PLA_A_Axis_Bearing_Base_Stand_Mount_Bottom_REVB:1 ↔ DIN 125-1 A A 5,3:14
- Mate:747: 3DP_PLA_A_Axis_Bearing_Base_Stand_Mount_Bottom_REVB:1 ↔ DIN 125-1 A A 5,3:14
- Mate:748: 3DP_PLA_A_Axis_Bearing_Base_Stand_Mount_Bottom_REVB:1 ↔ DIN 125-1 A A 5,3:15
- Mate:749: 3DP_PLA_A_Axis_Bearing_Base_Stand_Mount_Bottom_REVB:1 ↔ DIN 125-1 A A 5,3:15
- Insert:18: DIN 912 - replaced by DIN EN ISO 4762 M5 x 30:7 ↔ DIN 125-1 A A 5,3:7
- Insert:19: DIN 912 - replaced by DIN EN ISO 4762 M5 x 30:8 ↔ DIN 125-1 A A 5,3:8
- Insert:20: DIN 912 - replaced by DIN EN ISO 4762 M5 x 30:9 ↔ DIN 125-1 A A 5,3:9
- Insert:21: DIN 912 - replaced by DIN EN ISO 4762 M5 x 30:10 ↔ DIN 125-1 A A 5,3:10
- Insert:22: DIN 912 - replaced by DIN EN ISO 4762 M5 x 30:11 ↔ DIN 125-1 A A 5,3:11
- Insert:23: DIN 912 - replaced by DIN EN ISO 4762 M5 x 30:12 ↔ DIN 125-1 A A 5,3:12
- Insert:24: DIN 912 - replaced by DIN EN ISO 4762 M5 x 30:13 ↔ DIN 125-1 A A 5,3:13
- Insert:25: DIN 912 - replaced by DIN EN ISO 4762 M5 x 30:14 ↔ DIN 125-1 A A 5,3:14
- Insert:26: DIN 912 - replaced by DIN EN ISO 4762 M5 x 30:15 ↔ DIN 125-1 A A 5,3:15
- Mate:750: 3DP_PLA_A_Axis_Bearing_Base_Stand_Mount_Bottom_REVB:1 ↔ DIN 934 - replaced by DIN EN 24032/28673/28674 M5:27
- Mate:751: 3DP_PLA_A_Axis_Bearing_Base_Stand_Mount_REVB:1 ↔ DIN 934 - replaced by DIN EN 24032/28673/28674 M5:27
- Mate:752: 3DP_PLA_A_Axis_Bearing_Base_Stand_Mount_Bottom_REVB:1 ↔ DIN 934 - replaced by DIN EN 24032/28673/28674 M5:28
- Mate:753: 3DP_PLA_A_Axis_Bearing_Base_Stand_Mount_REVB:1 ↔ DIN 934 - replaced by DIN EN 24032/28673/28674 M5:28
- Mate:754: 3DP_PLA_A_Axis_Bearing_Base_Stand_Mount_Bottom_REVB:1 ↔ DIN 934 - replaced by DIN EN 24032/28673/28674 M5:29
- Mate:755: 3DP_PLA_A_Axis_Bearing_Base_Stand_Mount_REVB:1 ↔ DIN 934 - replaced by DIN EN 24032/28673/28674 M5:29
- Mate:756: 3DP_PLA_A_Axis_Bearing_Base_Stand_Mount_Bottom_REVB:1 ↔ DIN 934 - replaced by DIN EN 24032/28673/28674 M5:30
- Mate:757: 3DP_PLA_A_Axis_Bearing_Base_Stand_Mount_REVB:1 ↔ DIN 934 - replaced by DIN EN 24032/28673/28674 M5:30
- Mate:758: 3DP_PLA_A_Axis_Bearing_Base_Stand_Mount_Bottom_REVB:1 ↔ DIN 934 - replaced by DIN EN 24032/28673/28674 M5:31
- Mate:759: 3DP_PLA_A_Axis_Bearing_Base_Stand_Mount_REVB:1 ↔ DIN 934 - replaced by DIN EN 24032/28673/28674 M5:31
- Mate:760: 3DP_PLA_A_Axis_Bearing_Base_Stand_Mount_Bottom_REVB:1 ↔ DIN 934 - replaced by DIN EN 24032/28673/28674 M5:32
- Mate:761: 3DP_PLA_A_Axis_Bearing_Base_Stand_Mount_REVB:1 ↔ DIN 934 - replaced by DIN EN 24032/28673/28674 M5:32
- Mate:762: 3DP_PLA_A_Axis_Bearing_Base_Stand_Mount_Bottom_REVB:1 ↔ DIN 934 - replaced by DIN EN 24032/28673/28674 M5:33
- Mate:763: 3DP_PLA_A_Axis_Bearing_Base_Stand_Mount_REVB:1 ↔ DIN 934 - replaced by DIN EN 24032/28673/28674 M5:33
- Mate:764: 3DP_PLA_A_Axis_Bearing_Base_Stand_Mount_Bottom_REVB:1 ↔ DIN 934 - replaced by DIN EN 24032/28673/28674 M5:34
- Mate:765: 3DP_PLA_A_Axis_Bearing_Base_Stand_Mount_REVB:1 ↔ DIN 934 - replaced by DIN EN 24032/28673/28674 M5:34
- Mate:766: 3DP_PLA_A_Axis_Bearing_Base_Stand_Mount_Bottom_REVB:1 ↔ DIN 934 - replaced by DIN EN 24032/28673/28674 M5:35
- Mate:767: 3DP_PLA_A_Axis_Bearing_Base_Stand_Mount_REVB:1 ↔ DIN 934 - replaced by DIN EN 24032/28673/28674 M5:35
- Mate:768: 3DP_PLA_A_Axis_Bearing_Base_Stand_Mount_Bottom_REVB:1 ↔ DIN 125-1 A A 4,3:4
- Mate:769: 3DP_PLA_A_Axis_Bearing_Base_Stand_Mount_Bottom_REVB:1 ↔ DIN 125-1 A A 4,3:4
- Insert:27: DIN 912 - replaced by DIN EN ISO 4762 M4 x 10:1 ↔ DIN 125-1 A A 4,3:4
- Mate:770: 3DP_PLA_A_Axis_Bearing_Base_Stand_Bottom_Plate_REVB:1 ↔ COTS_Fleximo_FB12020_20x20_Alu_Profile_150mm:2
- Mate:771 (0.1 mm): 3DP_PLA_A_Axis_Bearing_Base_Stand_Bottom_Plate_REVB:1 ↔ COTS_Fleximo_FB12020_20x20_Alu_Profile_150mm:2
- Mate:772: 3DP_PLA_A_Axis_Bearing_Base_Stand_Bottom_Plate_REVB:1 ↔ COTS_Fleximo_FB12020_20x20_Alu_Profile_150mm:2
- Mate:773: COTS_Fleximo_FB12020_20x20_Alu_Profile_150mm:2 ↔ COTS_Fleximo_FB1NM4_M4_Nut_20x20:2
- Mate:774: COTS_Fleximo_FB12020_20x20_Alu_Profile_150mm:2 ↔ COTS_Fleximo_FB1NM4_M4_Nut_20x20:3
- Angle:72 (0 deg): COTS_Fleximo_FB12020_20x20_Alu_Profile_150mm:2 ↔ COTS_Fleximo_FB1NM4_M4_Nut_20x20:2
- Angle:73 (0 deg): COTS_Fleximo_FB12020_20x20_Alu_Profile_150mm:2 ↔ COTS_Fleximo_FB1NM4_M4_Nut_20x20:3
- Mate:775: 3DP_PLA_A_Axis_Bearing_Base_Stand_Bottom_Plate_REVB:1 ↔ COTS_Fleximo_FB1NM4_M4_Nut_20x20:2
- Mate:776: 3DP_PLA_A_Axis_Bearing_Base_Stand_Bottom_Plate_REVB:1 ↔ COTS_Fleximo_FB1NM4_M4_Nut_20x20:3
- Mate:777: 3DP_PLA_A_Axis_Bearing_Base_Stand_Bottom_Plate_REVB:1 ↔ DIN 125-1 A A 4,3:5
- Mate:778: 3DP_PLA_A_Axis_Bearing_Base_Stand_Bottom_Plate_REVB:1 ↔ DIN 125-1 A A 4,3:5
- Mate:779: 3DP_PLA_A_Axis_Bearing_Base_Stand_Bottom_Plate_REVB:1 ↔ DIN 125-1 A A 4,3:6
- Mate:780: 3DP_PLA_A_Axis_Bearing_Base_Stand_Bottom_Plate_REVB:1 ↔ DIN 125-1 A A 4,3:6
- Insert:28: DIN 125-1 A A 4,3:5 ↔ DIN 912 - replaced by DIN EN ISO 4762 M4 x 16:1
- Insert:29: DIN 912 - replaced by DIN EN ISO 4762 M4 x 16:2 ↔ DIN 125-1 A A 4,3:6
- Mate:781: 3DP_PLA_A_Axis_Bearing_Base:1 ↔ 3DP_PLA_A_Axis_Bearing_Base_Stand_Mount_REVB:1
- Mate:782: 3DP_PLA_A_Axis_Bearing_Base:1 ↔ DIN 125-1 A A 5,3:16
- Mate:783: 3DP_PLA_A_Axis_Bearing_Base:1 ↔ DIN 125-1 A A 5,3:16
- Mate:784: 3DP_PLA_A_Axis_Bearing_Base:1 ↔ DIN 125-1 A A 5,3:17
- Mate:785: 3DP_PLA_A_Axis_Bearing_Base:1 ↔ DIN 125-1 A A 5,3:17
- Mate:786: 3DP_PLA_A_Axis_Bearing_Base:1 ↔ DIN 125-1 A A 5,3:18
- Mate:787: 3DP_PLA_A_Axis_Bearing_Base:1 ↔ DIN 125-1 A A 5,3:18
- Mate:788: 3DP_PLA_A_Axis_Bearing_Base:1 ↔ DIN 125-1 A A 5,3:19
- Mate:789: 3DP_PLA_A_Axis_Bearing_Base:1 ↔ DIN 125-1 A A 5,3:19
- Mate:790: 3DP_PLA_A_Axis_Bearing_Base:1 ↔ DIN 125-1 A A 5,3:20
- Mate:791: 3DP_PLA_A_Axis_Bearing_Base:1 ↔ DIN 125-1 A A 5,3:20
- Mate:792: 3DP_PLA_A_Axis_Bearing_Base:1 ↔ DIN 125-1 A A 5,3:21
- Mate:793: 3DP_PLA_A_Axis_Bearing_Base:1 ↔ DIN 125-1 A A 5,3:21
- Insert:30: DIN 912 - replaced by DIN EN ISO 4762 M5 x 30:16 ↔ DIN 125-1 A A 5,3:16
- Insert:31: DIN 912 - replaced by DIN EN ISO 4762 M5 x 30:17 ↔ DIN 125-1 A A 5,3:17
- Insert:32: DIN 912 - replaced by DIN EN ISO 4762 M5 x 30:18 ↔ DIN 125-1 A A 5,3:18
- Insert:33: DIN 912 - replaced by DIN EN ISO 4762 M5 x 30:19 ↔ DIN 125-1 A A 5,3:19
- Insert:34: DIN 912 - replaced by DIN EN ISO 4762 M5 x 30:20 ↔ DIN 125-1 A A 5,3:20
- Insert:35: DIN 912 - replaced by DIN EN ISO 4762 M5 x 30:21 ↔ DIN 125-1 A A 5,3:21
- Mate:794: 3DP_PLA_A_Axis_Bearing_Base:1 ↔ DIN 934 - replaced by DIN EN 24032/28673/28674 M5:36
- Mate:795: 3DP_PLA_A_Axis_Bearing_Base_Stand_Mount_REVB:1 ↔ DIN 934 - replaced by DIN EN 24032/28673/28674 M5:36
- Mate:796: 3DP_PLA_A_Axis_Bearing_Base:1 ↔ DIN 934 - replaced by DIN EN 24032/28673/28674 M5:37
- Mate:797: 3DP_PLA_A_Axis_Bearing_Base_Stand_Mount_REVB:1 ↔ DIN 934 - replaced by DIN EN 24032/28673/28674 M5:37
- Mate:798: 3DP_PLA_A_Axis_Bearing_Base:1 ↔ DIN 934 - replaced by DIN EN 24032/28673/28674 M5:38
- Mate:799: 3DP_PLA_A_Axis_Bearing_Base_Stand_Mount_REVB:1 ↔ DIN 934 - replaced by DIN EN 24032/28673/28674 M5:38
- Mate:800: 3DP_PLA_A_Axis_Bearing_Base:1 ↔ DIN 934 - replaced by DIN EN 24032/28673/28674 M5:39
- Mate:801: 3DP_PLA_A_Axis_Bearing_Base_Stand_Mount_REVB:1 ↔ DIN 934 - replaced by DIN EN 24032/28673/28674 M5:39
- Mate:802: 3DP_PLA_A_Axis_Bearing_Base:1 ↔ DIN 934 - replaced by DIN EN 24032/28673/28674 M5:40
- Mate:803: 3DP_PLA_A_Axis_Bearing_Base_Stand_Mount_REVB:1 ↔ DIN 934 - replaced by DIN EN 24032/28673/28674 M5:40
- Mate:804: 3DP_PLA_A_Axis_Bearing_Base:1 ↔ DIN 934 - replaced by DIN EN 24032/28673/28674 M5:41
- Mate:805: 3DP_PLA_A_Axis_Bearing_Base_Stand_Mount_REVB:1 ↔ DIN 934 - replaced by DIN EN 24032/28673/28674 M5:41
- Mate:818: 3DP_PLA_Power_Brick_Mounting_Clamp_REVB:1 ↔ COTS_Fleximo_FB12020_20x20_Alu_Profile_600mm:2
- Mate:819: 3DP_PLA_Power_Brick_Mounting_Clamp_REVB:2 ↔ COTS_Fleximo_FB12020_20x20_Alu_Profile_600mm:2
- Mate:820: 3DP_PLA_Power_Brick_Mounting_Clamp_REVB:3 ↔ COTS_Fleximo_FB12020_20x20_Alu_Profile_600mm:2
- Mate:821: 3DP_PLA_Power_Brick_Mounting_Clamp_REVB:4 ↔ COTS_Fleximo_FB12020_20x20_Alu_Profile_600mm:2
- Mate:822: 3DP_PLA_Power_Brick_Mounting_Clamp_REVB:4 ↔ COTS_Fleximo_FB12020_20x20_Alu_Profile_600mm:2
- Mate:824: 3DP_PLA_Power_Brick_Mounting_Clamp_REVB:3 ↔ COTS_Fleximo_FB12020_20x20_Alu_Profile_600mm:2
- Mate:825: 3DP_PLA_Power_Brick_Mounting_Clamp_REVB:2 ↔ COTS_Fleximo_FB12020_20x20_Alu_Profile_600mm:2
- Flush:43: 3DP_PLA_Power_Brick_Mounting_Clamp_REVB:2 ↔ 3DP_PLA_Power_Brick_Mounting_Clamp_REVB:3
- Flush:44: 3DP_PLA_Power_Brick_Mounting_Clamp_REVB:1 ↔ 3DP_PLA_Power_Brick_Mounting_Clamp_REVB:4
- Mate:826: 3DP_PLA_Power_Brick_Mounting_Clamp_REVB:1 ↔ COTS_Fleximo_FB12020_20x20_Alu_Profile_600mm:2
- Mate:827: COTS_GENERIC_24V_Power_Brick:1 ↔ 3DP_PLA_Power_Brick_Mounting_Clamp_REVB:4
- Mate:828 (-0.2 mm): COTS_GENERIC_24V_Power_Brick:1 ↔ 3DP_PLA_Power_Brick_Mounting_Clamp_REVB:1
- Mate:829 (125 mm): 3DP_PLA_Power_Brick_Mounting_Clamp_REVB:1 ↔ 3DP_PLA_Power_Brick_Mounting_Clamp_REVB:2
- Flush:45 (-20 mm): COTS_GENERIC_24V_Power_Brick:1 ↔ 3DP_PLA_Power_Brick_Mounting_Clamp_REVB:1
- Mate:830 (150 mm): 3DP_PLA_Power_Brick_Mounting_Clamp_REVB:2 ↔ COTS_Fleximo_FB12020_20x20_Alu_Profile_150mm:3
- Mate:831: 3DP_PLA_Power_Brick_Mounting_Clamp_REVB:1 ↔ DIN 125-1 A A 4,3:13
- Mate:832: 3DP_PLA_Power_Brick_Mounting_Clamp_REVB:1 ↔ DIN 125-1 A A 4,3:13
- Mate:833: 3DP_PLA_Power_Brick_Mounting_Clamp_REVB:2 ↔ DIN 125-1 A A 4,3:15
- Mate:834: 3DP_PLA_Power_Brick_Mounting_Clamp_REVB:1 ↔ DIN 125-1 A A 4,3:15
- Mate:835: 3DP_PLA_Power_Brick_Mounting_Clamp_REVB:2 ↔ DIN 125-1 A A 4,3:16
- Mate:836: 3DP_PLA_Power_Brick_Mounting_Clamp_REVB:1 ↔ DIN 125-1 A A 4,3:16
- Mate:837: 3DP_PLA_Power_Brick_Mounting_Clamp_REVB:1 ↔ DIN 125-1 A A 4,3:17
- Mate:838: 3DP_PLA_Power_Brick_Mounting_Clamp_REVB:1 ↔ DIN 125-1 A A 4,3:17
- Insert:36: DIN 912 - replaced by DIN EN ISO 4762 M4 x 20:9 ↔ DIN 125-1 A A 4,3:13
- Insert:37: DIN 912 - replaced by DIN EN ISO 4762 M4 x 20:10 ↔ DIN 125-1 A A 4,3:15
- Insert:38: DIN 912 - replaced by DIN EN ISO 4762 M4 x 20:11 ↔ DIN 125-1 A A 4,3:16
- Insert:39: DIN 912 - replaced by DIN EN ISO 4762 M4 x 20:12 ↔ DIN 125-1 A A 4,3:17
- Mate:839: 3DP_PLA_Power_Brick_Mounting_Clamp_REVB:1 ↔ DIN 125-1 A A 4,3:14
- Mate:840: 3DP_PLA_Power_Brick_Mounting_Clamp_REVB:4 ↔ DIN 125-1 A A 4,3:14
- Mate:841: 3DP_PLA_Power_Brick_Mounting_Clamp_REVB:2 ↔ DIN 125-1 A A 4,3:18
- Mate:842: 3DP_PLA_Power_Brick_Mounting_Clamp_REVB:4 ↔ DIN 125-1 A A 4,3:18
- Mate:843: 3DP_PLA_Power_Brick_Mounting_Clamp_REVB:2 ↔ DIN 125-1 A A 4,3:19
- Mate:844: 3DP_PLA_Power_Brick_Mounting_Clamp_REVB:4 ↔ DIN 125-1 A A 4,3:19
- Mate:845: 3DP_PLA_Power_Brick_Mounting_Clamp_REVB:1 ↔ DIN 125-1 A A 4,3:20
- Mate:846: 3DP_PLA_Power_Brick_Mounting_Clamp_REVB:4 ↔ DIN 125-1 A A 4,3:20
- Insert:40: DIN 934 - replaced by DIN EN 24032/28673/28674 M4:29 ↔ DIN 125-1 A A 4,3:14
- Insert:41: DIN 934 - replaced by DIN EN 24032/28673/28674 M4:30 ↔ DIN 125-1 A A 4,3:18
- Insert:42: DIN 934 - replaced by DIN EN 24032/28673/28674 M4:31 ↔ DIN 125-1 A A 4,3:19
- Insert:43: DIN 934 - replaced by DIN EN 24032/28673/28674 M4:32 ↔ DIN 125-1 A A 4,3:20
- Mate:847: 3DP_PLA_Power_Brick_Mounting_Clamp_REVB:1 ↔ DIN 912 - replaced by DIN EN ISO 4762 M4 x 10:4
- Mate:848: 3DP_PLA_Power_Brick_Mounting_Clamp_REVB:1 ↔ DIN 912 - replaced by DIN EN ISO 4762 M4 x 10:4
- Mate:849: 3DP_PLA_Power_Brick_Mounting_Clamp_REVB:2 ↔ DIN 912 - replaced by DIN EN ISO 4762 M4 x 10:5
- Mate:850: 3DP_PLA_Power_Brick_Mounting_Clamp_REVB:1 ↔ DIN 912 - replaced by DIN EN ISO 4762 M4 x 10:5
- Mate:851: 3DP_PLA_Power_Brick_Mounting_Clamp_REVB:4 ↔ DIN 912 - replaced by DIN EN ISO 4762 M4 x 10:6
- Mate:852: 3DP_PLA_Power_Brick_Mounting_Clamp_REVB:4 ↔ DIN 912 - replaced by DIN EN ISO 4762 M4 x 10:6
- Mate:853: 3DP_PLA_Power_Brick_Mounting_Clamp_REVB:3 ↔ DIN 912 - replaced by DIN EN ISO 4762 M4 x 10:7
- Mate:854: 3DP_PLA_Power_Brick_Mounting_Clamp_REVB:4 ↔ DIN 912 - replaced by DIN EN ISO 4762 M4 x 10:7
- Mate:855: COTS_Fleximo_FB12020_20x20_Alu_Profile_600mm:1 ↔ 3DP_PLA_Alu_Frame_Brace_REVB:1
- Flush:46: COTS_Fleximo_FB12020_20x20_Alu_Profile_600mm:1 ↔ 3DP_PLA_Alu_Frame_Brace_REVB:1
- Mate:856: COTS_Fleximo_FB12020_20x20_Alu_Profile_150mm:1 ↔ 3DP_PLA_Alu_Frame_Brace_REVB:1
- Mate:857: COTS_Fleximo_FB12020_20x20_Alu_Profile_600mm:2 ↔ 3DP_PLA_Alu_Frame_Brace_REVB:2
- Flush:47: COTS_Fleximo_FB12020_20x20_Alu_Profile_600mm:2 ↔ 3DP_PLA_Alu_Frame_Brace_REVB:2
- Mate:858: COTS_Fleximo_FB12020_20x20_Alu_Profile_150mm:3 ↔ 3DP_PLA_Alu_Frame_Brace_REVB:2
- Mate:859: 3DP_PLA_Alu_Frame_Brace_REVB:2 ↔ LC_3mm_ALU_Alu_Frame_Brace_REVB:1
- Mate:860: 3DP_PLA_Alu_Frame_Brace_REVB:1 ↔ LC_3mm_ALU_Alu_Frame_Brace_REVB:1
- Angle:74 (0 deg): 3DP_PLA_Alu_Frame_Brace_REVB:2 ↔ LC_3mm_ALU_Alu_Frame_Brace_REVB:1
- Mate:861: 3DP_PLA_Alu_Frame_Brace_REVB:2 ↔ DIN 125-1 A A 4,3:21
- Mate:862: 3DP_PLA_Alu_Frame_Brace_REVB:2 ↔ DIN 125-1 A A 4,3:21
- Mate:863: 3DP_PLA_Alu_Frame_Brace_REVB:2 ↔ DIN 125-1 A A 4,3:22
- Mate:864: 3DP_PLA_Alu_Frame_Brace_REVB:2 ↔ DIN 125-1 A A 4,3:22
- Insert:44: DIN 125-1 A A 4,3:21 ↔ DIN 912 - replaced by DIN EN ISO 4762 M4 x 10:8
- Insert:45: DIN 125-1 A A 4,3:22 ↔ DIN 912 - replaced by DIN EN ISO 4762 M4 x 10:9
- Mate:865: 3DP_PLA_Alu_Frame_Brace_REVB:1 ↔ DIN 125-1 A A 4,3:23
- Mate:866: 3DP_PLA_Alu_Frame_Brace_REVB:1 ↔ DIN 125-1 A A 4,3:23
- Mate:867: 3DP_PLA_Alu_Frame_Brace_REVB:1 ↔ DIN 125-1 A A 4,3:24
- Mate:868: 3DP_PLA_Alu_Frame_Brace_REVB:1 ↔ DIN 125-1 A A 4,3:24
- Insert:46: DIN 125-1 A A 4,3:23 ↔ DIN 912 - replaced by DIN EN ISO 4762 M4 x 10:10
- Insert:47: DIN 125-1 A A 4,3:24 ↔ DIN 912 - replaced by DIN EN ISO 4762 M4 x 10:11
- Mate:869: LC_3mm_ALU_Alu_Frame_Brace_REVB:1 ↔ DIN 125-1 A A 4,3:25
- Mate:870: LC_3mm_ALU_Alu_Frame_Brace_REVB:1 ↔ DIN 125-1 A A 4,3:25